# Autodesk Inventor assembly: Montagem do sistema de engrenagem
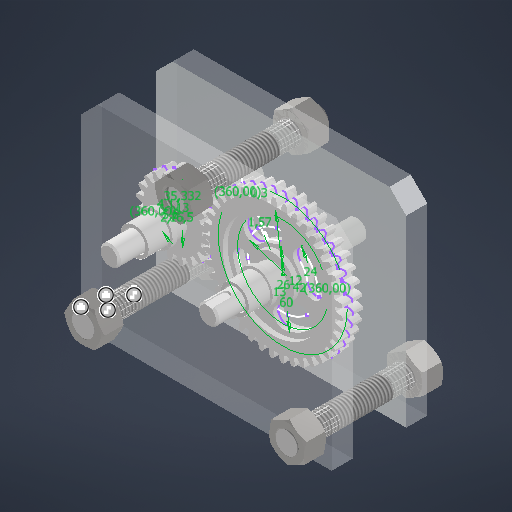
[picture p0: Inventor's stored thumbnail of the model, 512x512]
Saved by Autodesk Inventor 2026.2 (Build 302298000, 298)
## iProperties
Created: 2026-09-18
Part Number: Montagem do sistema de engrenagem
Document SubType Name: Assembly
Designer: IFSP
Author: IFSP
## Documents named in this file (10)
- D:\Montagem do sistema de engrenagem.iam
- D:\Chapa(engrenagem).ipt
- D:\Engrenagem 5.ipt
- D:\Engrenagem 4 novo.ipt
- D:\Engrenagem 8 novo.ipt
- D:\Engrenagem 7.ipt
- D:\Engrenagem maior.ipt
- D:\Engrenagem menor.ipt
- C:\Users\IFSP\Documents\Inventor\Content Center Files\R2026\pt-BR\ANSI B 18.2.4.1 M(1)\ANSI B 18.2.4.1 M - M14 x 2Style 1.ipt
- D:\Engrenagem 6.ipt
## Components (23 placed, 9 different names)
1. Chapa(engrenagem):1 — Coincidente:1, Coincidente:2, Coincidente:3, Coincidente:4, Coincidente:5, Coincidente:8, Coincidente:9, Coincidente:28, Coincidente:30, Coincidente:32
2. Chapa(engrenagem):2 — Coincidente:37, Coincidente:39, Coincidente:42, Coincidente:43
3. Engrenagem 5:1 — Coincidente:1, Alinhado:3, Coincidente:27, Coincidente:38
4. Engrenagem 5:2 — Coincidente:2, Alinhado:4, Coincidente:31, Coincidente:41
5. Engrenagem 5:3 — Coincidente:3, Alinhado:5, Coincidente:29, Coincidente:40
6. Engrenagem 4 novo:1 — Coincidente:4, Coincidente:6, Coincidente:10, Coincidente:14, Alinhado:1, Coincidente:25, Coincidente:33
7. Engrenagem 8 novo:1 — Coincidente:5, Coincidente:7, Coincidente:12, Coincidente:16, Alinhado:2, Coincidente:21, Coincidente:35
8. Engrenagem 7:7 — Coincidente:35, Coincidente:36
9. Engrenagem 7:8 — Coincidente:33, Coincidente:34, Coincidente:37
10. Engrenagem maior:1 — Coincidente:14, Coincidente:15, Rotação:1, Coincidente:18, Coincidente:23, Coincidente:24, Coincidente:26
11. Engrenagem menor:1 — Coincidente:16, Coincidente:17, Rotação:1, Coincidente:19, Coincidente:22
12. Porca sextavada Métrica M14 x 2:1 — Coincidente:27, Coincidente:28
13. Porca sextavada Métrica M14 x 2:2 — Coincidente:29, Coincidente:30
14. Porca sextavada Métrica M14 x 2:3 — Coincidente:31, Coincidente:32
15. Porca sextavada Métrica M14 x 2:4 — Coincidente:38, Coincidente:39
16. Porca sextavada Métrica M14 x 2:5 — Coincidente:40, Coincidente:43
17. Porca sextavada Métrica M14 x 2:6 — Coincidente:41, Coincidente:42
18. Engrenagem 7:9 — Coincidente:6, Coincidente:8, Coincidente:11
19. Engrenagem 7:10 — Coincidente:7, Coincidente:9, Coincidente:13
20. Engrenagem 6:1 — Coincidente:10, Coincidente:11, Coincidente:15
21. Engrenagem 6:2 — Coincidente:12, Coincidente:13, Coincidente:17
22. Engrenagem 6:3 — Coincidente:21, Coincidente:22, Coincidente:36
23. Engrenagem 6:5 — Coincidente:25, Coincidente:26, Coincidente:34
## Relationships (48: Mate 42, Flush 5, RelateRotation 1)
- Coincidente:1 [Mate]: Chapa(engrenagem):1 ↔ Engrenagem 5:1
- Coincidente:2 [Mate]: Chapa(engrenagem):1 ↔ Engrenagem 5:2
- Coincidente:3 [Mate]: Chapa(engrenagem):1 ↔ Engrenagem 5:3
- Coincidente:4 [Mate]: Chapa(engrenagem):1 ↔ Engrenagem 4 novo:1
- Coincidente:5 [Mate]: Chapa(engrenagem):1 ↔ Engrenagem 8 novo:1
- Coincidente:6 [Mate]: Engrenagem 4 novo:1 ↔ Engrenagem 7:9
- Coincidente:7 [Mate]: Engrenagem 8 novo:1 ↔ Engrenagem 7:10
- Coincidente:8 [Mate]: Chapa(engrenagem):1 ↔ Engrenagem 7:9
- Coincidente:9 [Mate]: Chapa(engrenagem):1 ↔ Engrenagem 7:10
- Coincidente:10 [Mate]: Engrenagem 4 novo:1 ↔ Engrenagem 6:1
- Coincidente:11 [Mate]: Engrenagem 7:9 ↔ Engrenagem 6:1
- Coincidente:12 [Mate]: Engrenagem 8 novo:1 ↔ Engrenagem 6:2
- Coincidente:13 [Mate]: Engrenagem 7:10 ↔ Engrenagem 6:2
- Coincidente:14 [Mate]: Engrenagem 4 novo:1 ↔ Engrenagem maior:1
- Coincidente:15 [Mate]: Engrenagem maior:1 ↔ Engrenagem 6:1
- Coincidente:16 [Mate]: Engrenagem 8 novo:1 ↔ Engrenagem menor:1
- Coincidente:17 [Mate]: Engrenagem menor:1 ↔ Engrenagem 6:2
- Rotação:1 [RelateRotation] (1 ul): Engrenagem maior:1 ↔ Engrenagem menor:1
- Alinhado:1 [Flush] (-45 mm): Engrenagem 4 novo:1
- Coincidente:18 [Mate]: Engrenagem maior:1
- Alinhado:2 [Flush] (-44 mm): Engrenagem 8 novo:1
- Coincidente:19 [Mate]: Engrenagem menor:1
- Coincidente:21 [Mate]: Engrenagem 8 novo:1 ↔ Engrenagem 6:3
- Coincidente:22 [Mate]: Engrenagem menor:1 ↔ Engrenagem 6:3
- Alinhado:3 [Flush] (-41.7 mm): Engrenagem 5:1
- Alinhado:4 [Flush] (-41.7 mm): Engrenagem 5:2
- Alinhado:5 [Flush] (-41.7 mm): Engrenagem 5:3
- Coincidente:23 [Mate]: Engrenagem maior:1
- Coincidente:24 [Mate]: Engrenagem maior:1
- Coincidente:25 [Mate]: Engrenagem 4 novo:1 ↔ Engrenagem 6:5
- Coincidente:26 [Mate]: Engrenagem maior:1 ↔ Engrenagem 6:5
- Coincidente:27 [Mate]: Engrenagem 5:1 ↔ Porca sextavada Métrica M14 x 2:1
- Coincidente:28 [Mate]: Chapa(engrenagem):1 ↔ Porca sextavada Métrica M14 x 2:1
- Coincidente:29 [Mate]: Engrenagem 5:3 ↔ Porca sextavada Métrica M14 x 2:2
- Coincidente:30 [Mate]: Chapa(engrenagem):1 ↔ Porca sextavada Métrica M14 x 2:2
- Coincidente:31 [Mate]: Engrenagem 5:2 ↔ Porca sextavada Métrica M14 x 2:3
- Coincidente:32 [Mate]: Chapa(engrenagem):1 ↔ Porca sextavada Métrica M14 x 2:3
- Coincidente:33 [Mate]: Engrenagem 4 novo:1 ↔ Engrenagem 7:8
- Coincidente:34 [Mate]: Engrenagem 7:8 ↔ Engrenagem 6:5
- Coincidente:35 [Mate]: Engrenagem 8 novo:1 ↔ Engrenagem 7:7
- Coincidente:36 [Mate]: Engrenagem 7:7 ↔ Engrenagem 6:3
- Coincidente:37 [Mate]: Chapa(engrenagem):2 ↔ Engrenagem 7:8
- Coincidente:38 [Mate]: Engrenagem 5:1 ↔ Porca sextavada Métrica M14 x 2:4
- Coincidente:39 [Mate]: Chapa(engrenagem):2 ↔ Porca sextavada Métrica M14 x 2:4
- Coincidente:40 [Mate]: Engrenagem 5:3 ↔ Porca sextavada Métrica M14 x 2:5
- Coincidente:41 [Mate]: Engrenagem 5:2 ↔ Porca sextavada Métrica M14 x 2:6
- Coincidente:42 [Mate]: Chapa(engrenagem):2 ↔ Porca sextavada Métrica M14 x 2:6
- Coincidente:43 [Mate]: Chapa(engrenagem):2 ↔ Porca sextavada Métrica M14 x 2:5
## Named parameters: Finish1_Area = 643.823, Finish2_Area = 172.274
note: some values were not read from the file. Shown as the stored number, unit unknown: "Finish1_Area", "Finish2_Area".
